# Autodesk Inventor assembly: OBIKE_v4
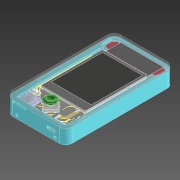
[picture p0: Inventor's stored thumbnail of the model, 180x180]
Saved by Autodesk Inventor 2020.1 (Build 241239000, 239)
## iProperties
Created: 2026-10-11
Part Number: OBIKE_v4
Document SubType Name: Assembly
Designer: willn
Author: willn
## Documents named in this file (10)
- C:\Repos\bike_telemetry\3D_CAD\OBIKE_v4.iam
- C:\Repos\Obike 3d\OBike v3_2.iam
- C:\Users\willn\Documents\projects\bike_computer\nubbin.ipt
- C:\Repos\Obike 3d\IPS screen.ipt
- C:\Repos\Obike 3d\506080_batt.ipt
- C:\Repos\bike_telemetry\3D_CAD\ant.ipt
- C:\Repos\bike_telemetry\3D_CAD\outer shell.ipt
- C:\Repos\bike_telemetry\3D_CAD\back.ipt
- C:\Repos\bike_telemetry\3D_CAD\ant_support.ipt
- C:\Repos\bike_telemetry\3D_CAD\clear_front.ipt
## Components (9 placed, 9 different names)
1. OBike v3_2:1 [sub-assembly] — Mate:1, Mate:2, Angle:1, Mate:3, Mate:4, Mate:5, Mate:6, Mate:8, Mate:9, Mate:10, Flush:2, Mate:15, Mate:17, Mate:20
2. nubbin:1 — Mate:3, Mate:4, Mate:5
3. IPS screen:1 — Mate:1, Mate:2, Angle:1, Mate:11, Flush:1
4. 506080_batt:1 — Mate:13, Mate:14, Mate:16
5. ant:1 — Mate:10, Mate:11, Flush:1, Flush:3
6. outer shell:1 — Flush:2, Mate:15, Mate:17, Mate:18, Mate:19, Flush:4
7. back:1 — Mate:13, Mate:14, Mate:16, Mate:18, Mate:19, Mate:20
8. ant_support:1 — Flush:3
9. clear_front:1 — Flush:4
## Relationships (23: Mate 18, Flush 4, Angle 1)
- Mate:1: OBike v3_2:1 ↔ IPS screen:1
- Mate:2: OBike v3_2:1 ↔ IPS screen:1
- Angle:1 (0 deg): OBike v3_2:1 ↔ IPS screen:1
- Mate:3: OBike v3_2:1 ↔ nubbin:1
- Mate:4 (0.1 mm): OBike v3_2:1 ↔ nubbin:1
- Mate:5 (0.1 mm): OBike v3_2:1 ↔ nubbin:1
- Mate:6: OBike v3_2:1
- Mate:8: OBike v3_2:1
- Mate:9: OBike v3_2:1
- Mate:10: OBike v3_2:1 ↔ ant:1
- Mate:11: IPS screen:1 ↔ ant:1
- Flush:1 (-1 mm): IPS screen:1 ↔ ant:1
- Flush:2: OBike v3_2:1 ↔ outer shell:1
- Mate:13: 506080_batt:1 ↔ back:1
- Mate:14: 506080_batt:1 ↔ back:1
- Mate:15 (0.05 mm): OBike v3_2:1 ↔ outer shell:1
- Mate:16: 506080_batt:1 ↔ back:1
- Mate:17 (0.05 mm): OBike v3_2:1 ↔ outer shell:1
- Mate:18 (0.2 mm): outer shell:1 ↔ back:1
- Mate:19 (0.2 mm): outer shell:1 ↔ back:1
- Mate:20: OBike v3_2:1 ↔ back:1
- Flush:3: ant:1 ↔ ant_support:1
- Flush:4: outer shell:1 ↔ clear_front:1
